# Autodesk Inventor assembly: assemble
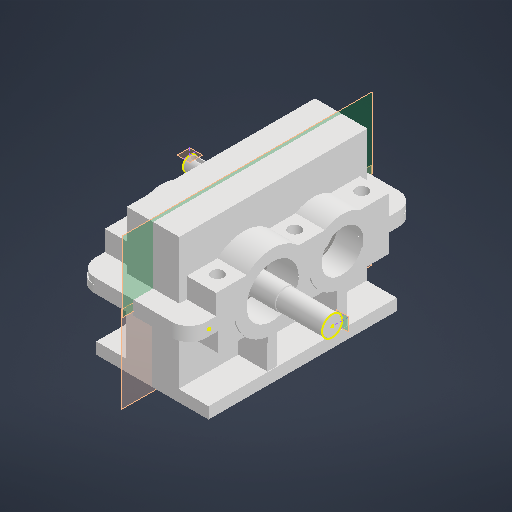
[picture p0: Inventor's stored thumbnail of the model, 512x512]
Saved by Autodesk Inventor 2026 (Build 300175000, 175)
## iProperties
Created: 2026-08-27
Part Number: assemble
Document SubType Name: Assembly
Designer: 14170
Author: 14170
## Documents named in this file (9)
- C:\Users\14170\Desktop\研究生课题\test\reducer\assemble.iam
- C:\Users\14170\Desktop\研究生课题\test\reducer\箱座.ipt
- C:\Users\14170\Desktop\研究生课题\test\reducer\箱盖.ipt
- C:\Users\14170\Desktop\研究生课题\test\reducer\assemble\设计加速器\轴承1.iam
- C:\Users\14170\Desktop\研究生课题\test\reducer\高速轴.ipt
- C:\Users\14170\Desktop\研究生课题\test\reducer\低速轴.ipt
- C:\Users\14170\Desktop\研究生课题\test\reducer\低速大齿轮.ipt
- C:\Users\14170\Desktop\研究生课题\test\reducer\assemble\设计加速器\键联接1.iam
- C:\Users\14170\Desktop\研究生课题\test\reducer\assemble\设计加速器\轴承2.iam
## Components (10 placed, 7 different names)
1. 箱座:1 — 配合:1, 配合:2, 配合:12, 配合:13, 配合:14, 配合:15, 配合:16
2. 箱盖:1 — 配合:1, 配合:2, 配合:12
3. 轴承:1 [sub-assembly] — 插入:1, 配合:13
4. 轴承:2 [sub-assembly] — 插入:2, 配合:15
5. 高速轴:1 — 插入:1, 插入:2
6. 低速轴:1 — 配合:6, 刚性:1, 旋转:1, 插入:3, 插入:4
7. 低速大齿轮:1 — 配合:6, 旋转:1
8. 键联接:1 [sub-assembly] — 刚性:1
9. 轴承:3 [sub-assembly] — 插入:3, 配合:14
10. 轴承:4 [sub-assembly] — 插入:4, 配合:16
## Relationships (14: Mate 8, Insert 4, WeldJoint 1, RevoluteJoint 1)
- 配合:1 [Mate]: 箱座:1 ↔ 箱盖:1
- 配合:2 [Mate]: 箱座:1 ↔ 箱盖:1
- 插入:1 [Insert] (6 mm): 轴承:1 ↔ 高速轴:1
- 插入:2 [Insert] (24 mm): 轴承:2 ↔ 高速轴:1
- 配合:6 [Mate]: 低速轴:1 ↔ 低速大齿轮:1
- 刚性:1 [WeldJoint]: 低速轴:1 ↔ 键联接:1
- 旋转:1 [RevoluteJoint]: 低速轴:1 ↔ 低速大齿轮:1
- 插入:3 [Insert] (15 mm): 低速轴:1 ↔ 轴承:3
- 插入:4 [Insert] (-18 mm): 低速轴:1 ↔ 轴承:4
- 配合:12 [Mate]: 箱座:1 ↔ 箱盖:1
- 配合:13 [Mate]: 箱座:1 ↔ 轴承:1
- 配合:14 [Mate]: 箱座:1 ↔ 轴承:3
- 配合:15 [Mate]: 箱座:1 ↔ 轴承:2
- 配合:16 [Mate]: 箱座:1 ↔ 轴承:4
